# Autodesk Inventor assembly: BG009_thutrn22_26
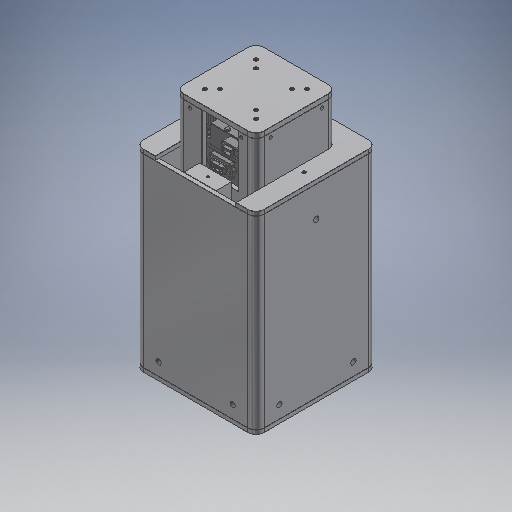
[picture p0: Inventor's stored thumbnail of the model, 512x512]
Saved by Autodesk Inventor 2025.3 (Build 293356000, 356)
## iProperties
Company: HTBLA Kaindorf
RuleStatus: InUse
Created: 2026-08-18
Part Number: BG009_thutrn22_26
Project: Biegeroboter
Material: Generisch
Description: gehaeuse_gesamt_v3
Document SubType Name: Assembly
Designer: thutrn22
Mass: 3686.12 g
Surface Area: 6929.62 cm^2
Volume: 3608.41 cm^3
Density: 1.02154 g/cm^3
AfterDocNew0: iProperties-Editor_aufrufen
Author: trist
Keywords: 2026
## Documents named in this file (11)
- C:\Users\trist\Desktop\Schule\diplomarbeit_dateien\Mechanik\Biegekopf\Gehäuse\BG009_thutrn22_26_Biegeroboter_gehaeuse_gesamt_v3.iam
- C:\Users\trist\Desktop\Schule\diplomarbeit_dateien\Mechanik\Biegekopf\MATSUSHITA_MSMF082L1U1\AIS2024\MSMF082L1U1.iam
- C:\Users\trist\Desktop\Schule\diplomarbeit_dateien\Mechanik\Biegekopf\188635080-9-gearbox_ab115-100-s2-p2-12\gearbox_ab115-100-s2-p2-12.ipt
- C:\Users\trist\Desktop\Schule\diplomarbeit_dateien\Mechanik\Biegekopf\Gehäuse\DIN EN 10219-2 - 100 x 100 x 5  - 130.ipt
- C:\Users\trist\Desktop\Schule\diplomarbeit_dateien\Mechanik\Biegekopf\Gehäuse\DIN EN 10219-2 - 150 x 150 x 5  - 230.ipt
- C:\Users\trist\Desktop\Schule\diplomarbeit_dateien\Mechanik\Biegekopf\Gehäuse\BT021_thutrn22_26_Biegeroboter_distanzleiste.ipt
- C:\Users\trist\Desktop\Schule\diplomarbeit_dateien\Mechanik\Biegekopf\Gehäuse\BT022_thutrn22_26_Biegeroboter_gehaeuse_deckel_motor_v3.ipt
- C:\Users\trist\Desktop\Schule\diplomarbeit_dateien\Mechanik\Biegekopf\Gehäuse\BT023_thutrn22_26_Biegeroboter_halterung_getriebe.ipt
- C:\Users\trist\Desktop\Schule\diplomarbeit_dateien\Mechanik\Biegekopf\Gehäuse\BT024_thutrn22_26_Biegeroboter_halterung_motor.ipt
- C:\Users\trist\Desktop\Schule\diplomarbeit_dateien\Mechanik\Biegekopf\Gehäuse\BT025_thutrn22_26_Biegeroboter_gehaeuse_deckel_getriebe.ipt
- C:\Users\trist\Desktop\Schule\diplomarbeit_dateien\Mechanik\Biegekopf\Gehäuse\BT026_thutrn22_26_Biegeroboter_gehaeuse_getriebe_deckel_oben.ipt
## Components (23 placed, 10 different names)
1. DIN EN 10219-2 - 100 x 100 x 5  - 130:1 — Passend:12, Passend:13, Fluchtend:5, Passend:14, Passend:15, Passend:16, Passend:17, Fluchtend:6, Fluchtend:7, Passend:18, Passend:19, Fluchtend:8, Passend:20, Passend:21, Fluchtend:9, Passend:22, Passend:23, Fluchtend:10, Passend:24, Passend:25, Fluchtend:11, Passend:26, Passend:27, Fluchtend:12, Passend:42, Fluchtend:13, Fluchtend:14, Passend:48, Passend:49, Passend:50, Passend:51, Passend:52, Passend:53, Passend:54, Passend:55, Passend:56, Passend:62
2. DIN EN 10219-2 - 150 x 150 x 5  - 230:1 — Passend:1, Passend:2, Fluchtend:1, Passend:3, Passend:4, Fluchtend:2, Passend:5, Passend:6, Fluchtend:3, Passend:7, Passend:8, Fluchtend:4, Passend:43, Fluchtend:15, Fluchtend:16, Passend:57, Fluchtend:17, Fluchtend:18
3. BT023_thutrn22_26_Biegeroboter_halterung_getriebe:1 — Passend:7, Passend:8, Fluchtend:4
4. BT023_thutrn22_26_Biegeroboter_halterung_getriebe:2 — Passend:1, Passend:2, Fluchtend:1
5. BT023_thutrn22_26_Biegeroboter_halterung_getriebe:3 — Passend:3, Passend:4, Fluchtend:2, Passend:11, Passend:59
6. BT023_thutrn22_26_Biegeroboter_halterung_getriebe:4 — Passend:5, Passend:6, Fluchtend:3, Passend:58
7. gearbox_ab115-100-s2-p2-12:1 — Passend:11, Passend:40, Passend:47, Passend:58, Passend:59
8. BT024_thutrn22_26_Biegeroboter_halterung_motor:1 — Passend:14, Passend:15, Fluchtend:7
9. BT024_thutrn22_26_Biegeroboter_halterung_motor:2 — Passend:18, Passend:19, Fluchtend:8
10. BT024_thutrn22_26_Biegeroboter_halterung_motor:3 — Passend:22, Passend:23, Fluchtend:10, Passend:39, Passend:60
11. BT024_thutrn22_26_Biegeroboter_halterung_motor:4 — Passend:24, Passend:25, Fluchtend:11
12. BT024_thutrn22_26_Biegeroboter_halterung_motor:5 — Passend:12, Passend:13, Fluchtend:5
13. BT024_thutrn22_26_Biegeroboter_halterung_motor:6 — Passend:16, Passend:17, Fluchtend:6
14. BT024_thutrn22_26_Biegeroboter_halterung_motor:7 — Passend:20, Passend:21, Fluchtend:9, Passend:38
15. BT024_thutrn22_26_Biegeroboter_halterung_motor:8 — Passend:26, Passend:27, Fluchtend:12, Passend:37, Passend:61
16. BT021_thutrn22_26_Biegeroboter_distanzleiste:1 — Passend:51, Passend:52, Passend:53
17. BT021_thutrn22_26_Biegeroboter_distanzleiste:2 — Passend:48, Passend:49, Passend:50
18. BT021_thutrn22_26_Biegeroboter_distanzleiste:4 — Passend:54, Passend:55, Passend:56
19. MSMF082L1U1:1 [sub-assembly] — Passend:37, Passend:38, Passend:39, Passend:40, Passend:47, Passend:60, Passend:61
20. BT022_thutrn22_26_Biegeroboter_gehaeuse_deckel_motor_v3:1 — Passend:42, Fluchtend:13, Fluchtend:14
21. BT025_thutrn22_26_Biegeroboter_gehaeuse_deckel_getriebe:1 — Passend:43, Fluchtend:15, Fluchtend:16
22. BT026_thutrn22_26_Biegeroboter_gehaeuse_getriebe_deckel_oben:1 — Passend:57, Fluchtend:17, Fluchtend:18, Passend:62
23. BT021_thutrn22_26_Biegeroboter_distanzleiste:5
## Relationships (65: Mate 47, Flush 18)
- Passend:1 [Mate]: DIN EN 10219-2 - 150 x 150 x 5  - 230:1 ↔ BT023_thutrn22_26_Biegeroboter_halterung_getriebe:2
- Passend:2 [Mate]: DIN EN 10219-2 - 150 x 150 x 5  - 230:1 ↔ BT023_thutrn22_26_Biegeroboter_halterung_getriebe:2
- Fluchtend:1 [Flush] (10.5 mm): DIN EN 10219-2 - 150 x 150 x 5  - 230:1 ↔ BT023_thutrn22_26_Biegeroboter_halterung_getriebe:2
- Passend:3 [Mate]: DIN EN 10219-2 - 150 x 150 x 5  - 230:1 ↔ BT023_thutrn22_26_Biegeroboter_halterung_getriebe:3
- Passend:4 [Mate]: DIN EN 10219-2 - 150 x 150 x 5  - 230:1 ↔ BT023_thutrn22_26_Biegeroboter_halterung_getriebe:3
- Fluchtend:2 [Flush] (10.5 mm): DIN EN 10219-2 - 150 x 150 x 5  - 230:1 ↔ BT023_thutrn22_26_Biegeroboter_halterung_getriebe:3
- Passend:5 [Mate]: DIN EN 10219-2 - 150 x 150 x 5  - 230:1 ↔ BT023_thutrn22_26_Biegeroboter_halterung_getriebe:4
- Passend:6 [Mate]: DIN EN 10219-2 - 150 x 150 x 5  - 230:1 ↔ BT023_thutrn22_26_Biegeroboter_halterung_getriebe:4
- Fluchtend:3 [Flush] (10.5 mm): DIN EN 10219-2 - 150 x 150 x 5  - 230:1 ↔ BT023_thutrn22_26_Biegeroboter_halterung_getriebe:4
- Passend:7 [Mate]: DIN EN 10219-2 - 150 x 150 x 5  - 230:1 ↔ BT023_thutrn22_26_Biegeroboter_halterung_getriebe:1
- Passend:8 [Mate]: DIN EN 10219-2 - 150 x 150 x 5  - 230:1 ↔ BT023_thutrn22_26_Biegeroboter_halterung_getriebe:1
- Fluchtend:4 [Flush] (10.5 mm): DIN EN 10219-2 - 150 x 150 x 5  - 230:1 ↔ BT023_thutrn22_26_Biegeroboter_halterung_getriebe:1
- Passend:11 [Mate]: BT023_thutrn22_26_Biegeroboter_halterung_getriebe:3 ↔ gearbox_ab115-100-s2-p2-12:1
- Passend:12 [Mate]: DIN EN 10219-2 - 100 x 100 x 5  - 130:1 ↔ BT024_thutrn22_26_Biegeroboter_halterung_motor:5
- Passend:13 [Mate]: DIN EN 10219-2 - 100 x 100 x 5  - 130:1 ↔ BT024_thutrn22_26_Biegeroboter_halterung_motor:5
- Fluchtend:5 [Flush]: DIN EN 10219-2 - 100 x 100 x 5  - 130:1 ↔ BT024_thutrn22_26_Biegeroboter_halterung_motor:5
- Passend:14 [Mate]: DIN EN 10219-2 - 100 x 100 x 5  - 130:1 ↔ BT024_thutrn22_26_Biegeroboter_halterung_motor:1
- Passend:15 [Mate]: DIN EN 10219-2 - 100 x 100 x 5  - 130:1 ↔ BT024_thutrn22_26_Biegeroboter_halterung_motor:1
- Passend:16 [Mate]: DIN EN 10219-2 - 100 x 100 x 5  - 130:1 ↔ BT024_thutrn22_26_Biegeroboter_halterung_motor:6
- Passend:17 [Mate]: DIN EN 10219-2 - 100 x 100 x 5  - 130:1 ↔ BT024_thutrn22_26_Biegeroboter_halterung_motor:6
- Fluchtend:6 [Flush]: DIN EN 10219-2 - 100 x 100 x 5  - 130:1 ↔ BT024_thutrn22_26_Biegeroboter_halterung_motor:6
- Fluchtend:7 [Flush]: DIN EN 10219-2 - 100 x 100 x 5  - 130:1 ↔ BT024_thutrn22_26_Biegeroboter_halterung_motor:1
- Passend:18 [Mate]: DIN EN 10219-2 - 100 x 100 x 5  - 130:1 ↔ BT024_thutrn22_26_Biegeroboter_halterung_motor:2
- Passend:19 [Mate]: DIN EN 10219-2 - 100 x 100 x 5  - 130:1 ↔ BT024_thutrn22_26_Biegeroboter_halterung_motor:2
- Fluchtend:8 [Flush]: DIN EN 10219-2 - 100 x 100 x 5  - 130:1 ↔ BT024_thutrn22_26_Biegeroboter_halterung_motor:2
- Passend:20 [Mate]: DIN EN 10219-2 - 100 x 100 x 5  - 130:1 ↔ BT024_thutrn22_26_Biegeroboter_halterung_motor:7
- Passend:21 [Mate]: DIN EN 10219-2 - 100 x 100 x 5  - 130:1 ↔ BT024_thutrn22_26_Biegeroboter_halterung_motor:7
- Fluchtend:9 [Flush] (-10.5 mm): DIN EN 10219-2 - 100 x 100 x 5  - 130:1 ↔ BT024_thutrn22_26_Biegeroboter_halterung_motor:7
- Passend:22 [Mate]: DIN EN 10219-2 - 100 x 100 x 5  - 130:1 ↔ BT024_thutrn22_26_Biegeroboter_halterung_motor:3
- Passend:23 [Mate]: DIN EN 10219-2 - 100 x 100 x 5  - 130:1 ↔ BT024_thutrn22_26_Biegeroboter_halterung_motor:3
- Fluchtend:10 [Flush] (10.5 mm): DIN EN 10219-2 - 100 x 100 x 5  - 130:1 ↔ BT024_thutrn22_26_Biegeroboter_halterung_motor:3
- Passend:24 [Mate]: DIN EN 10219-2 - 100 x 100 x 5  - 130:1 ↔ BT024_thutrn22_26_Biegeroboter_halterung_motor:4
- Passend:25 [Mate]: DIN EN 10219-2 - 100 x 100 x 5  - 130:1 ↔ BT024_thutrn22_26_Biegeroboter_halterung_motor:4
- Fluchtend:11 [Flush] (10.5 mm): DIN EN 10219-2 - 100 x 100 x 5  - 130:1 ↔ BT024_thutrn22_26_Biegeroboter_halterung_motor:4
- Passend:26 [Mate]: DIN EN 10219-2 - 100 x 100 x 5  - 130:1 ↔ BT024_thutrn22_26_Biegeroboter_halterung_motor:8
- Passend:27 [Mate]: DIN EN 10219-2 - 100 x 100 x 5  - 130:1 ↔ BT024_thutrn22_26_Biegeroboter_halterung_motor:8
- Fluchtend:12 [Flush] (10.5 mm): DIN EN 10219-2 - 100 x 100 x 5  - 130:1 ↔ BT024_thutrn22_26_Biegeroboter_halterung_motor:8
- Passend:37 [Mate]: BT024_thutrn22_26_Biegeroboter_halterung_motor:8 ↔ MSMF082L1U1:1
- Passend:38 [Mate]: BT024_thutrn22_26_Biegeroboter_halterung_motor:7 ↔ MSMF082L1U1:1
- Passend:39 [Mate]: BT024_thutrn22_26_Biegeroboter_halterung_motor:3 ↔ MSMF082L1U1:1
- Passend:40 [Mate]: gearbox_ab115-100-s2-p2-12:1 ↔ MSMF082L1U1:1
- Passend:42 [Mate]: DIN EN 10219-2 - 100 x 100 x 5  - 130:1 ↔ BT022_thutrn22_26_Biegeroboter_gehaeuse_deckel_motor_v3:1
- Fluchtend:13 [Flush]: DIN EN 10219-2 - 100 x 100 x 5  - 130:1 ↔ BT022_thutrn22_26_Biegeroboter_gehaeuse_deckel_motor_v3:1
- Fluchtend:14 [Flush]: DIN EN 10219-2 - 100 x 100 x 5  - 130:1 ↔ BT022_thutrn22_26_Biegeroboter_gehaeuse_deckel_motor_v3:1
- Passend:43 [Mate]: DIN EN 10219-2 - 150 x 150 x 5  - 230:1 ↔ BT025_thutrn22_26_Biegeroboter_gehaeuse_deckel_getriebe:1
- Fluchtend:15 [Flush]: DIN EN 10219-2 - 150 x 150 x 5  - 230:1 ↔ BT025_thutrn22_26_Biegeroboter_gehaeuse_deckel_getriebe:1
- Fluchtend:16 [Flush]: DIN EN 10219-2 - 150 x 150 x 5  - 230:1 ↔ BT025_thutrn22_26_Biegeroboter_gehaeuse_deckel_getriebe:1
- Passend:47 [Mate]: gearbox_ab115-100-s2-p2-12:1 ↔ MSMF082L1U1:1
- Passend:48 [Mate]: DIN EN 10219-2 - 100 x 100 x 5  - 130:1 ↔ BT021_thutrn22_26_Biegeroboter_distanzleiste:2
- Passend:49 [Mate]: DIN EN 10219-2 - 100 x 100 x 5  - 130:1 ↔ BT021_thutrn22_26_Biegeroboter_distanzleiste:2
- Passend:50 [Mate]: DIN EN 10219-2 - 100 x 100 x 5  - 130:1 ↔ BT021_thutrn22_26_Biegeroboter_distanzleiste:2
- Passend:51 [Mate]: DIN EN 10219-2 - 100 x 100 x 5  - 130:1 ↔ BT021_thutrn22_26_Biegeroboter_distanzleiste:1
- Passend:52 [Mate]: DIN EN 10219-2 - 100 x 100 x 5  - 130:1 ↔ BT021_thutrn22_26_Biegeroboter_distanzleiste:1
- Passend:53 [Mate]: DIN EN 10219-2 - 100 x 100 x 5  - 130:1 ↔ BT021_thutrn22_26_Biegeroboter_distanzleiste:1
- Passend:54 [Mate]: DIN EN 10219-2 - 100 x 100 x 5  - 130:1 ↔ BT021_thutrn22_26_Biegeroboter_distanzleiste:4
- Passend:55 [Mate]: DIN EN 10219-2 - 100 x 100 x 5  - 130:1 ↔ BT021_thutrn22_26_Biegeroboter_distanzleiste:4
- Passend:56 [Mate]: DIN EN 10219-2 - 100 x 100 x 5  - 130:1 ↔ BT021_thutrn22_26_Biegeroboter_distanzleiste:4
- Passend:57 [Mate]: DIN EN 10219-2 - 150 x 150 x 5  - 230:1 ↔ BT026_thutrn22_26_Biegeroboter_gehaeuse_getriebe_deckel_oben:1
- Fluchtend:17 [Flush]: DIN EN 10219-2 - 150 x 150 x 5  - 230:1 ↔ BT026_thutrn22_26_Biegeroboter_gehaeuse_getriebe_deckel_oben:1
- Fluchtend:18 [Flush]: DIN EN 10219-2 - 150 x 150 x 5  - 230:1 ↔ BT026_thutrn22_26_Biegeroboter_gehaeuse_getriebe_deckel_oben:1
- Passend:58 [Mate]: BT023_thutrn22_26_Biegeroboter_halterung_getriebe:4 ↔ gearbox_ab115-100-s2-p2-12:1
- Passend:59 [Mate]: BT023_thutrn22_26_Biegeroboter_halterung_getriebe:3 ↔ gearbox_ab115-100-s2-p2-12:1
- Passend:60 [Mate]: BT024_thutrn22_26_Biegeroboter_halterung_motor:3 ↔ MSMF082L1U1:1
- Passend:61 [Mate]: BT024_thutrn22_26_Biegeroboter_halterung_motor:8 ↔ MSMF082L1U1:1
- Passend:62 [Mate]: DIN EN 10219-2 - 100 x 100 x 5  - 130:1 ↔ BT026_thutrn22_26_Biegeroboter_gehaeuse_getriebe_deckel_oben:1
